# Autodesk Inventor assembly: a
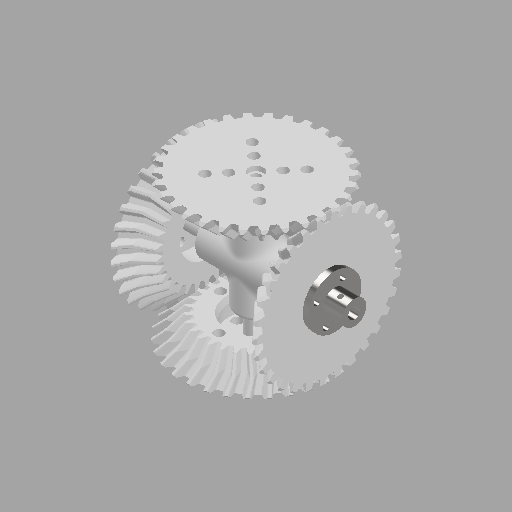
[picture p0: Inventor's stored thumbnail of the model, 512x512]
Saved by Autodesk Inventor 2026.2 (Build 302298010, 298A)
## iProperties
Created: 2026-03-18
Part Number: a
Document SubType Name: Assembly
Designer: work
Author: work
## Documents named in this file (13)
- C:\Users\khw\Desktop\ARD_v1\ARD_hardware\ARD_Model_v1\a.iam
- C:\Users\khw\Desktop\ARD_v1\ARD_hardware\ARD_Model_v1\1\A.ipt
- C:\Users\khw\Desktop\ARD_v1\ARD_hardware\ARD_Model_v1\C.ipt
- C:\Users\khw\Desktop\ARD_v1\ARD_hardware\ARD_Model_v1\5_Co.ipt
- C:\Users\khw\Desktop\ARD_v1\ARD_hardware\ARD_Model_v1\1\B.ipt
- C:\Users\khw\Desktop\ARD_v1\ARD_hardware\ARD_Model_v1\2B_set\AIP\FEA\fdflh83ds.fins
- C:\Users\khw\Desktop\ARD_v1\ARD_hardware\ARD_Model_v1\2B_set\AIP\FEA\fdflh83ds.fsat
- C:\Users\khw\Desktop\ARD_v1\ARD_hardware\ARD_Model_v1\2B_set\AIP\FEA\fdflh83ds.ftes
- C:\Users\khw\Desktop\ARD_v1\ARD_hardware\ARD_Model_v1\2B_set\AIP\FEA\fdflh83ds.fwiz
- C:\Users\khw\Desktop\ARD_v1\ARD_hardware\ARD_Model_v1\a\AIP\FEA\fdmw1xa9s.fins
- C:\Users\khw\Desktop\ARD_v1\ARD_hardware\ARD_Model_v1\a\AIP\FEA\fdmw1xa9s.fsat
- C:\Users\khw\Desktop\ARD_v1\ARD_hardware\ARD_Model_v1\a\AIP\FEA\fdmw1xa9s.ftes
- C:\Users\khw\Desktop\ARD_v1\ARD_hardware\ARD_Model_v1\a\AIP\FEA\fdmw1xa9s.fwiz
## Components (7 placed, 4 different names)
1. B:2 — 회전:3
2. A:1 — 메이트:11, 메이트:22, 메이트:23, 회전:1
3. C:1 — 메이트:10, 메이트:11, 메이트:27
4. A:2 — 메이트:10, 메이트:21, 메이트:24, 회전:2
5. 5_Co:4 — 메이트:22, 메이트:23
6. 5_Co:3 — 메이트:21, 메이트:24, 회전:3
7. B:1 — 메이트:27, 회전:1, 회전:2
## Relationships (10: Mate 7, RelateRotation 3)
- 메이트:10 [Mate]: C:1 ↔ A:2
- 메이트:11 [Mate]: A:1 ↔ C:1
- 메이트:21 [Mate]: A:2 ↔ 5_Co:3
- 메이트:22 [Mate]: A:1 ↔ 5_Co:4
- 메이트:23 [Mate]: A:1 ↔ 5_Co:4
- 메이트:24 [Mate]: A:2 ↔ 5_Co:3
- 메이트:27 [Mate]: C:1 ↔ B:1
- 회전:1 [RelateRotation] (1 ul): A:1 ↔ B:1
- 회전:2 [RelateRotation] (1 ul): A:2 ↔ B:1
- 회전:3 [RelateRotation] (1 ul): B:2 ↔ 5_Co:3
## Named parameters: sa_0 = 10000
note: some values were not read from the file. Shown as the stored number, unit unknown: "sa_0".
